# Autodesk Inventor assembly: robot
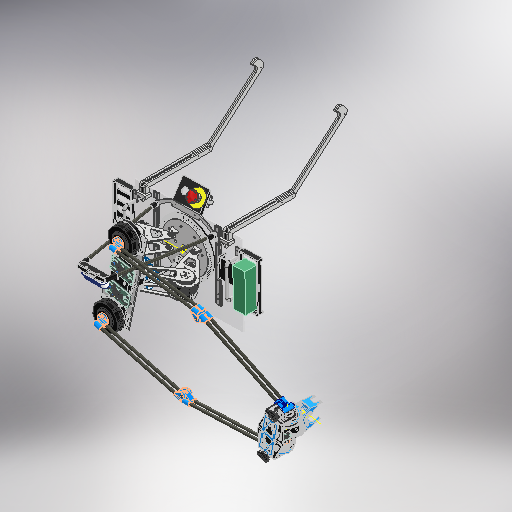
[picture p0: Inventor's stored thumbnail of the model, 512x512]
Saved by Autodesk Inventor 2025.3 (Build 293356030, 356C)
## iProperties
Created: 2026-02-11
Part Number: robot
Document SubType Name: Assembly
Designer: ibuki_ono
Author: ibuki_ono
## Documents named in this file (5)
- C:\Users\ibuki_ono\Documents\hobby\rogiken\catchrobo\2026_CAD\Hardware_2026\Inventor\robot.iam
- C:\Users\ibuki_ono\Documents\hobby\rogiken\catchrobo\2026_CAD\Hardware_2026\Inventor\top_links\top.iam
- C:\Users\ibuki_ono\Documents\hobby\rogiken\catchrobo\2026_CAD\Hardware_2026\Inventor\base_table\base-roter.iam
- C:\Users\ibuki_ono\Documents\hobby\rogiken\catchrobo\2026_CAD\Hardware_2026\Inventor\End-Effector\end-effector.iam
- C:\Users\ibuki_ono\Documents\hobby\rogiken\catchrobo\2026_CAD\Hardware_2026\Inventor\base_table\PC_stand.iam
## Components (5 placed, 4 different names)
1. top:1 [sub-assembly] — 挿入:1, 挿入:2, 挿入:3, 挿入:4
2. base-roter:1 [sub-assembly] — 挿入:3, 挿入:4, メイト:1, メイト:2, メイト:3, メイト:4, メイト:5, メイト:6, メイト:7
3. end-effector:1 [sub-assembly] — 挿入:1, 挿入:2
4. PC_stand:1 [sub-assembly] — メイト:2, メイト:3, メイト:4
5. PC_stand:2 [sub-assembly] — メイト:5, メイト:6, メイト:7
## Relationships (11: Mate 7, Insert 4)
- 挿入:1 [Insert]: top:1 ↔ end-effector:1
- 挿入:2 [Insert]: top:1 ↔ end-effector:1
- 挿入:3 [Insert]: top:1 ↔ base-roter:1
- 挿入:4 [Insert]: top:1 ↔ base-roter:1
- メイト:1 [Mate]: base-roter:1
- メイト:2 [Mate]: base-roter:1 ↔ PC_stand:1
- メイト:3 [Mate]: base-roter:1 ↔ PC_stand:1
- メイト:4 [Mate] (1 mm): base-roter:1 ↔ PC_stand:1
- メイト:5 [Mate]: base-roter:1 ↔ PC_stand:2
- メイト:6 [Mate]: base-roter:1 ↔ PC_stand:2
- メイト:7 [Mate] (1 mm): base-roter:1 ↔ PC_stand:2
